# Autodesk Inventor assembly: 1.4_EndEffector
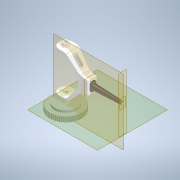
[picture p0: Inventor's stored thumbnail of the model, 180x180]
Saved by Autodesk Inventor 2021 (Build 250183000, 183)
## iProperties
Created: 2025-11-13
Part Number: 1.4_EndEffector
Document SubType Name: Assembly
Designer: Admin
Mass: 419.364 g
Surface Area: 485.084 cm^2
Volume: 210.545 cm^3
Density: 1.99181 g/cm^3
Author: Admin
## Documents named in this file (5)
- C:\Users\Admin\OneDrive - Politecnico di Milano\File di Erwin Rafael Novicio - Industrial Robotics SY 25-26\3D Model\COBOT - no shaftkeys\1.4_EndEffector.iam
- C:\Users\Admin\OneDrive - Politecnico di Milano\File di Erwin Rafael Novicio - Industrial Robotics SY 25-26\3D Model\COBOT - no shaftkeys\1.4_1_EndEffector.ipt
- C:\Users\Admin\OneDrive - Politecnico di Milano\File di Erwin Rafael Novicio - Industrial Robotics SY 25-26\3D Model\COBOT - no shaftkeys\Timing_Pulley_22002-051060_V1.ipt
- C:\Users\Admin\Documents\Inventor\Content Center Files\R2021\en-US\DIN 471(1)\DIN 471 - 14x1.ipt
- C:\Users\Admin\OneDrive - Politecnico di Milano\File di Erwin Rafael Novicio - Industrial Robotics SY 25-26\3D Model\COBOT - no shaftkeys\1.4_2_EndEffector.ipt
## Components (4 placed, 4 different names)
1. 1.4_1_EndEffector:1 — Mate:1, Flush:1, Flush:2, Mate:8, Mate:9, Mate:10, Mate:12, Mate:13, Mate:14, Mate:15
2. Timing_Pulley_22002-051060_V1:1 — Mate:10, Mate:12
3. DIN 471 14x1:1 — Mate:8, Mate:9
4. 1.4_2_EndEffector:1 — Mate:13, Mate:14, Mate:15
## Relationships (10: Mate 8, Flush 2)
- Mate:1: 1.4_1_EndEffector:1
- Flush:1: 1.4_1_EndEffector:1
- Flush:2: 1.4_1_EndEffector:1
- Mate:8: 1.4_1_EndEffector:1 ↔ DIN 471 14x1:1
- Mate:9: 1.4_1_EndEffector:1 ↔ DIN 471 14x1:1
- Mate:10: 1.4_1_EndEffector:1 ↔ Timing_Pulley_22002-051060_V1:1
- Mate:12: 1.4_1_EndEffector:1 ↔ Timing_Pulley_22002-051060_V1:1
- Mate:13: 1.4_1_EndEffector:1 ↔ 1.4_2_EndEffector:1
- Mate:14: 1.4_1_EndEffector:1 ↔ 1.4_2_EndEffector:1
- Mate:15: 1.4_1_EndEffector:1 ↔ 1.4_2_EndEffector:1
